# Autodesk Inventor assembly: Stabi_2_1_vers2
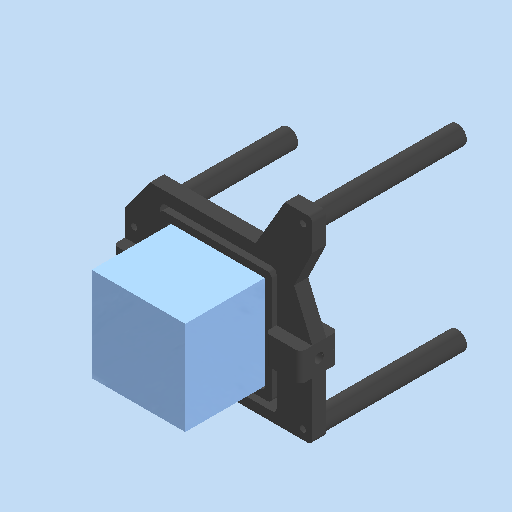
[picture p0: Inventor's stored thumbnail of the model, 512x512]
Saved by Autodesk Inventor 2026 (Build 300175050, 175E)
## iProperties
Created: 2025-06-25
Part Number: Stabi_2_1_vers2
Document SubType Name: Assembly
Designer: karle
Author: karle
## Documents named in this file (6)
- C:\Users\karle\OneDrive - HESSO\P2511_Dossier_partage_RVEZ\01_Robot\0101_CAO\2_Stabil\Stabi_2_1_vers2.iam
- C:\Users\karle\OneDrive - HESSO\P2511_Dossier_partage_RVEZ\01_Robot\0101_CAO\2_Stabil\2_01_stabilisateur_intérieur.ipt
- C:\Users\karle\OneDrive - HESSO\P2511_Dossier_partage_RVEZ\01_Robot\0101_CAO\2_Stabil\2_02_stabilisatuer_milieu_2.ipt
- C:\Users\karle\OneDrive - HESSO\P2511_Dossier_partage_RVEZ\01_Robot\0101_CAO\2_Stabil\2_02_stabilisatuer_milieu_1.ipt
- C:\Users\karle\OneDrive - HESSO\P2511_Dossier_partage_RVEZ\01_Robot\0101_CAO\2_Stabil\2_05_recipien_eau.ipt
- C:\Users\karle\OneDrive - HESSO\P2511_Dossier_partage_RVEZ\01_Robot\0101_CAO\2_Stabil\2_04_stabilisatuer_supports.ipt
## Components (8 placed, 5 different names)
1. 2_01_stabilisateur_intérieur:1 — Einfügen:2, Passend:2, Passend:3, Passend:4
2. 2_02_stabilisatuer_milieu_2:1 — Passend:1, Fluchtend:1, Einfügen:1, Einfügen:2, Einfügen:3, Einfügen:6
3. 2_02_stabilisatuer_milieu_1:1 — Passend:1, Fluchtend:1, Einfügen:1, Einfügen:4, Einfügen:5
4. 2_05_recipien_eau:1 — Passend:2, Passend:3, Passend:4
5. 2_04_stabilisatuer_supports:1 — Einfügen:3
6. 2_04_stabilisatuer_supports:2 — Einfügen:4
7. 2_04_stabilisatuer_supports:3 — Einfügen:5
8. 2_04_stabilisatuer_supports:4 — Einfügen:6
## Relationships (11: Insert 6, Mate 4, Flush 1)
- Passend:1 [Mate]: 2_02_stabilisatuer_milieu_2:1 ↔ 2_02_stabilisatuer_milieu_1:1
- Fluchtend:1 [Flush]: 2_02_stabilisatuer_milieu_2:1 ↔ 2_02_stabilisatuer_milieu_1:1
- Einfügen:1 [Insert]: 2_02_stabilisatuer_milieu_2:1 ↔ 2_02_stabilisatuer_milieu_1:1
- Einfügen:2 [Insert]: 2_01_stabilisateur_intérieur:1 ↔ 2_02_stabilisatuer_milieu_2:1
- Passend:2 [Mate]: 2_01_stabilisateur_intérieur:1 ↔ 2_05_recipien_eau:1
- Passend:3 [Mate]: 2_01_stabilisateur_intérieur:1 ↔ 2_05_recipien_eau:1
- Passend:4 [Mate]: 2_01_stabilisateur_intérieur:1 ↔ 2_05_recipien_eau:1
- Einfügen:3 [Insert]: 2_02_stabilisatuer_milieu_2:1 ↔ 2_04_stabilisatuer_supports:1
- Einfügen:4 [Insert]: 2_02_stabilisatuer_milieu_1:1 ↔ 2_04_stabilisatuer_supports:2
- Einfügen:5 [Insert]: 2_02_stabilisatuer_milieu_1:1 ↔ 2_04_stabilisatuer_supports:3
- Einfügen:6 [Insert]: 2_02_stabilisatuer_milieu_2:1 ↔ 2_04_stabilisatuer_supports:4
